# Autodesk Inventor assembly: SE0001AN000_G01_108
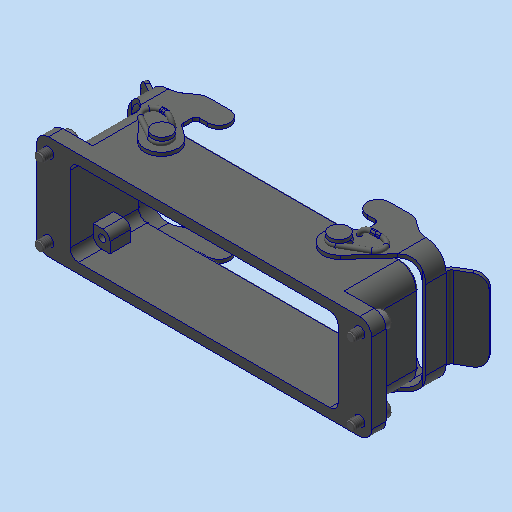
[picture p0: Inventor's stored thumbnail of the model, 512x512]
Saved by Autodesk Inventor 2023.3 (Build 273359000, 359)
## iProperties
Part Number: SE0001AN000_G01_108
Material: Generisch
Description: =<RBPARTNOTITLE2>
Document SubType Name: Assembly
Designer: Benutzer
Mass: 8.04402 g
Surface Area: 12.329 cm^2
Volume: 1.02472 cm^3
Density: 7.85 g/cm^3
RBCHANGEDESCRIPTION1: Erstfreigabe
RBCHANGENO1: 00
RBDOCUMENTTYPE: DRF
RBDOCUMENTVERSION: 00
RBDRAWINGMAINSCALE: 1:1
RBDRAWINGMISSINGSPEC: --
RBDRAWINGVOLUME: --
RBDSV1: 0850
RBGBDETAILS: 43274
RBGBEDGESIN1: +0,5
RBGBEDGESIN2: +0,2
RBGBEDGESOUT1: -0,3
RBGBEDGESOUT2: -0,1
RBMATERIAL: =<Material>
RBMATMEETS: --
RBMATNO: =<Part Number>
RBORGUNITRESPONSIBLE1: AnP/TEF1
RBPARTMADEOF: --
RBPARTNO: SIEHE MNR
RBPARTNOTITLE1: Base Plate with screws
RBPARTNOTITLE2: 24 B Anbaugehäuse mit Schrauben
RBPARTSAFETYINDICATOR: --
RBSURFACE: --
RBSURFACE2: --
RBZEDGESNORM: ISO13715:2002-06
RBZGENDIMCLASS: m
RBZGENDIMNORM: ISO 2768-1:1989-11
RBZGENGEOCLASS: H
RBZGENGEONORM: ISO 2768-2:1989-11
RBZSURFACENORM: ISO13D2:2002-02
RBZTOLERANCENORM: ISO 14405-1:2010-12
AnP_Kommentar: --
MaxAbmaße: --
AnP_TemplVers: 20190222
AnP_Kategorie: 98
AnP_Material: =<Material>
Author: Benutzer
Keywords: =<RBPARTMADEOF>
Revision Number: 01
## Documents named in this file (3)
- C:\Users\rea9an\Documents\Inventor\TCAI2412_te1910_EM\AS00000979.iam
- C:\Users\rea9an\Documents\Inventor\TCAI2412_te1910_EM\PT00004792.ipt
- C:\Users\rea9an\Documents\Inventor\TCAI2412_te1910_EM\PT00004866.ipt
## Components (5 placed, 2 different names)
1. PT00004792:1 — Einfügen:1, Einfügen:2, Einfügen:3, Einfügen:4
2. PT00004866:1 — Einfügen:1
3. PT00004866:2 — Einfügen:2
4. PT00004866:3 — Einfügen:3
5. PT00004866:4 — Einfügen:4
## Relationships (4: Insert 4)
- Einfügen:1 [Insert]: PT00004792:1 ↔ PT00004866:1
- Einfügen:2 [Insert]: PT00004792:1 ↔ PT00004866:2
- Einfügen:3 [Insert]: PT00004792:1 ↔ PT00004866:3
- Einfügen:4 [Insert]: PT00004792:1 ↔ PT00004866:4
